# Autodesk Inventor assembly: MM0948AN100_G22_001
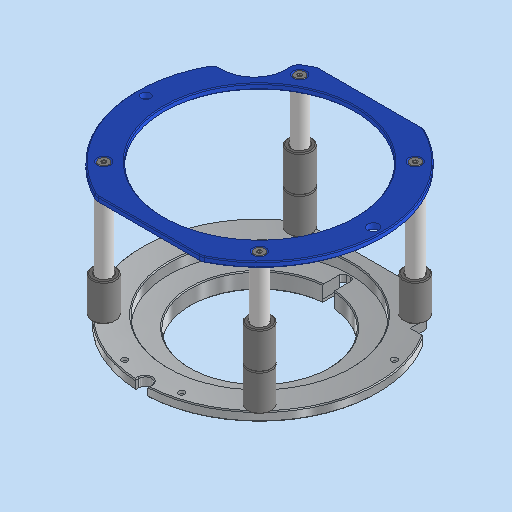
[picture p0: Inventor's stored thumbnail of the model, 512x512]
Saved by Autodesk Inventor 2023.3 (Build 273359000, 359)
## iProperties
RuleStatus: InUse
Created: 2023-03-23
Part Number: MM0948AN100_G22_001
Description: =<RBPARTNOTITLE2>
Document SubType Name: Assembly
Designer: FH/Wi
Mass: 379.199 g
Surface Area: 547.614 cm^2
Volume: 95.2108 cm^3
Density: 3.98273 g/cm^3
AnP_Kategorie: 99
AnP_Material: =<Material>
AnP_TemplVers: 20200821
RBDOCUMENTTYPE: DRF
RBDOCUMENTVERSION: 00
RBDRAWINGMAINSCALE: 1:1
RBDRAWINGMISSINGSPEC: --
RBDRAWINGVOLUME: --
RBDSV1: 0850
RBGBEDGESIN1: +0,5
RBGBEDGESIN2: +0,2
RBGBEDGESOUT1: -0,3
RBGBEDGESOUT2: -0,1
RBMATERIAL: =<Material>
RBMATMEETS: --
RBMATNO: =<Part Number>
RBPARTMADEOF: --
RBPARTNO: SIEHE MNR
RBPARTNOTITLE1: Cup Holder
RBPARTNOTITLE2: Becherhalter
RBPARTSAFETYINDICATOR: --
RBSURFACE: --
RBSURFACE2: --
RBZEDGESNORM: ISO13715:2002-06
RBZGENDIMCLASS: m
RBZGENDIMNORM: ISO 2768-1:1989-11
RBZGENGEOCLASS: H
RBZGENGEONORM: ISO 2768-2:1989-11
RBZSURFACENORM: ISO13D2:2002-02
RBZTOLERANCENORM: ISO 14405-1:2010-12
Author: FH/Wi
Keywords: =<RBPARTMADEOF>
Comments: =<RBSURFACE2>
Revision Number: 01
## Documents named in this file (7)
- C:\Users\rea9an\Documents\Inventor\TCAI2412_te1910_EM\AS00000935.iam
- C:\Users\rea9an\Documents\Inventor\TCAI2412_te1910_EM\PT00004863.ipt
- C:\Users\rea9an\Documents\Inventor\TCAI2412_te1910_EM\PT00004829.ipt
- C:\Users\rea9an\Documents\Inventor\TCAI2412_te1910_EM\PT00004622.ipt
- C:\Users\rea9an\Documents\Inventor\TCAI2412_te1910_EM\PT00004623.ipt
- C:\Users\rea9an\Documents\Inventor\TCAI2412_te1910_EM\PT00004602.ipt
- C:\Users\rea9an\Documents\Inventor\TCAI2412_te1910_EM\PT00004609.ipt
## Components (20 placed, 6 different names)
1. PT00004602:1 — Passend:20
2. PT00004622:2
3. PT00004622:3 — Passend:21
4. PT00004622:4 — Passend:23
5. PT00004622:1 — Passend:19, Passend:20, Passend:22
6. PT00004609:1
7. PT00004609:2
8. PT00004609:3
9. PT00004609:4
10. PT00004609:5
11. PT00004609:6
12. PT00004623:1 — Passend:21, Passend:22, Passend:23, Einfügen:12, Einfügen:13, Einfügen:14, Einfügen:15
13. PT00004863:1
14. PT00004863:2
15. PT00004829:1 — Einfügen:13
16. PT00004829:2 — Einfügen:14
17. PT00004863:3
18. PT00004863:4 — Passend:19
19. PT00004829:3 — Einfügen:12
20. PT00004829:4 — Einfügen:15
## Relationships (20: Insert 11, Mate 9)
- [Mate]: PT00004602:1 ↔ PT00004622:2
- [Mate]: PT00004602:1 ↔ PT00004622:3
- [Mate]: PT00004602:1 ↔ PT00004622:3
- [Insert]: PT00004602:1 ↔ PT00004863:1
- [Insert]: PT00004602:1 ↔ PT00004863:2
- [Mate]: PT00004602:1 ↔ PT00004622:2
- [Insert]: PT00004602:1 ↔ PT00004863:3
- [Insert]: PT00004602:1 ↔ PT00004863:4
- [Insert]: PT00004602:1 ↔ PT00004622:4
- Passend:19 [Mate]: PT00004622:1 ↔ PT00004863:4
- Passend:20 [Mate]: PT00004602:1 ↔ PT00004622:1
- Passend:21 [Mate]: PT00004622:3 ↔ PT00004623:1
- Passend:22 [Mate]: PT00004622:1 ↔ PT00004623:1
- Passend:23 [Mate]: PT00004622:4 ↔ PT00004623:1
- Einfügen:12 [Insert]: PT00004623:1 ↔ PT00004829:3
- Einfügen:13 [Insert]: PT00004623:1 ↔ PT00004829:1
- Einfügen:14 [Insert]: PT00004623:1 ↔ PT00004829:2
- Einfügen:15 [Insert]: PT00004623:1 ↔ PT00004829:4
- [Insert]: PT00004609:4 ↔ PT00004609:6
- [Insert]: PT00004609:1 ↔ PT00004609:5
